# Autodesk Inventor assembly: J-CV-10
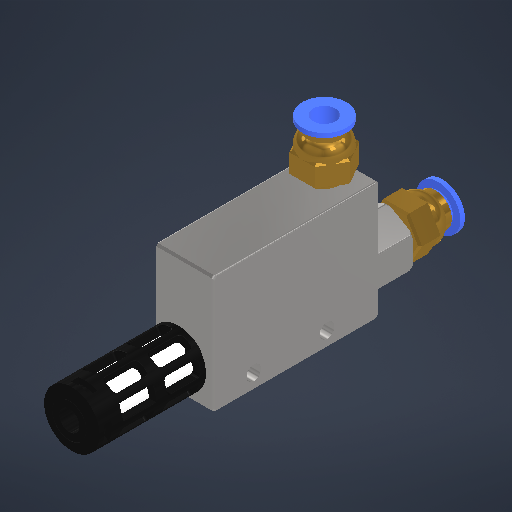
[picture p0: Inventor's stored thumbnail of the model, 512x512]
Saved by Autodesk Inventor 2026.2 (Build 302298010, 298A)
## iProperties
Created: 2026-05-09
Part Number: J-CV-10
Document SubType Name: Assembly
Designer: work
Author: work
## Documents named in this file (4)
- C:\Users\work\Desktop\ARD_v1\ARD_hardware\Pneumatic fitting\J-CV-10\J-CV-10.iam
- C:\Users\work\Desktop\ARD_v1\ARD_hardware\Pneumatic fitting\J-CV-10\filter.ipt
- C:\Users\work\Desktop\ARD_v1\ARD_hardware\Pneumatic fitting\J-CV-10\PC6-M5.ipt
- C:\Users\work\Desktop\ARD_v1\ARD_hardware\Pneumatic fitting\J-CV-10\CV10_body.ipt
## Components (4 placed, 3 different names)
1. filter:1 — 회전:1
2. PC6-M5:1 — 삽입:1
3. CV10_body:1 — 삽입:1, 삽입:2, 회전:1
4. PC6-M5:2 — 삽입:2
## Relationships (3: Insert 2, RevoluteJoint 1)
- 삽입:1 [Insert]: PC6-M5:1 ↔ CV10_body:1
- 삽입:2 [Insert]: CV10_body:1 ↔ PC6-M5:2
- 회전:1 [RevoluteJoint]: filter:1 ↔ CV10_body:1
